# Autodesk Inventor assembly: 1133 FP-250x1294x42
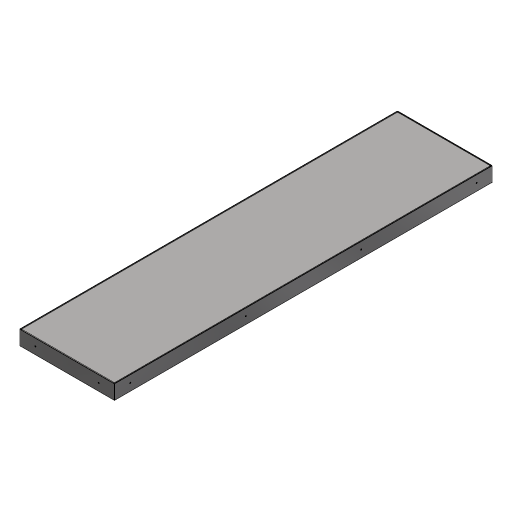
[picture p0: Inventor's stored thumbnail of the model, 512x512]
Saved by Autodesk Inventor 2024.3 (Build 283343000, 343)
## iProperties
RuleStatus: InUse
Created: 2019-06-24
Part Number: 1133 FP-250x1294x42
Material: Generisch
Document SubType Name: Assembly
Designer: MK
Mass: 7678.01 g
Surface Area: 19632 cm^2
Volume: 978.09 cm^3
Density: 7.85 g/cm^3
Description: Tür-Paneel
InventorSizerSetup: FP 1T 1
Author: MK
## Documents named in this file (3)
- C:\Users\la\Documents\GitHub\Inventor_Sizer\C# Version\masters\FP\1T\1133 FP-250x1294x42.iam
- C:\Users\la\Documents\GitHub\Inventor_Sizer\C# Version\masters\FP\1T\1133 250x1294x42-Au.ipt
- C:\Users\la\Documents\GitHub\Inventor_Sizer\C# Version\masters\FP\1T\1133 250x1294x42-In.ipt
## Components (2 placed, 2 different names)
1. 1133 250x1294x42-Au:1 — Mate:6, Mate:7, Mate:8
2. 1133 250x1294x42-In:1 — Mate:6, Mate:7, Mate:8
## Relationships (3: Mate 3)
- Mate:6: 1133 250x1294x42-Au:1 ↔ 1133 250x1294x42-In:1
- Mate:7 (0.5 mm): 1133 250x1294x42-Au:1 ↔ 1133 250x1294x42-In:1
- Mate:8 (0.5 mm): 1133 250x1294x42-Au:1 ↔ 1133 250x1294x42-In:1
## Named parameters: Clearance = 0.5 mm, HingeCount = 3, HingePitch = 537 mm, HandleCount = 4, HandlePitch = 298 mm, Width = 250 mm
